# Autodesk Inventor assembly: Cantoneira montada perfil x prateleira
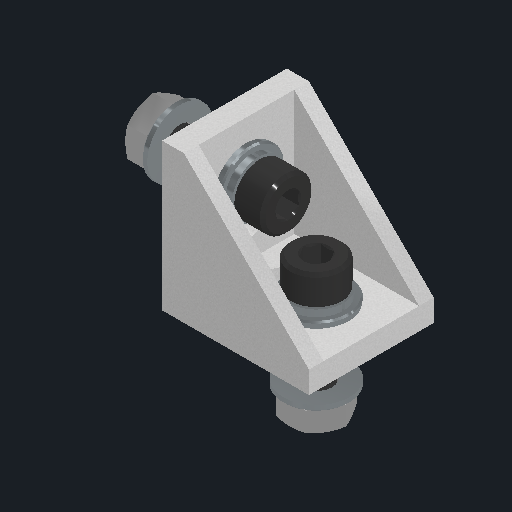
[picture p0: Inventor's stored thumbnail of the model, 512x512]
Saved by Autodesk Inventor 2026.1 (Build 301233000, 233)
## iProperties
Created: 2025-07-09
Part Number: Cantoneira montada perfil x prateleira
Document SubType Name: Assembly
Designer: Cliente
Mass: 13.7619 g
Surface Area: 41.0933 cm^2
Volume: 3.20103 cm^3
Density: 4.29922 g/cm^3
Author: Cliente
## Documents named in this file (6)
- C:\Users\Cliente\Desktop\TCC\Base\Fixação\Cantoneira montada manipulador.iam
- C:\Users\Cliente\Desktop\TCC\Base\Fixação\Cantoneira em alumínio 20X20X17.ipt
- C:\Users\Cliente\Desktop\TCC\Base\Fixação\Arruela Lisa DIN 125 - B4 - 300 HV.ipt
- C:\Users\Cliente\Desktop\TCC\Base\Fixação\Arruela de Pressão DIN 127 - B4.ipt
- C:\Users\Cliente\Desktop\TCC\Base\Fixação\Parafuso Allen Cabeça Cilíndrica DIN 912 - M4 - 12.9.ipt
- C:\Users\Cliente\Desktop\TCC\Base\Fixação\Porca Sextavada DIN 934 - M4 - 8.ipt
## Components (11 placed, 5 different names)
1. Cantoneira em alumínio 20X20X17:1 — Alinhado:1, Alinhado:2, Alinhado:3, Coincidente:1, Coincidente:2, Tangente:1, Tangente:2, Coincidente:14, Coincidente:17, Ângulo:1, Ângulo:2
2. Arruela Lisa DIN 125 - B4 - 300 HV:1 — Coincidente:1, Alinhado:4, Coincidente:6, Coincidente:7, Coincidente:11
3. Arruela Lisa DIN 125 - B4 - 300 HV:2 — Alinhado:5, Coincidente:2, Coincidente:3, Coincidente:4, Coincidente:8
4. Arruela de Pressão DIN 127 - B4:1 — Coincidente:3, Coincidente:4, Coincidente:5, Coincidente:9
5. Arruela de Pressão DIN 127 - B4:2 — Coincidente:6, Coincidente:7, Alinhado:6, Coincidente:10
6. Parafuso Allen Cabeça Cilíndrica DIN 912 - M4 - 12.9:1 — Alinhado:7, Coincidente:8, Coincidente:9, Tangente:1, Coincidente:15, Coincidente:18
7. Parafuso Allen Cabeça Cilíndrica DIN 912 - M4 - 12.9:2 — Alinhado:8, Coincidente:10, Coincidente:11, Tangente:2, Coincidente:12, Coincidente:19
8. Arruela Lisa DIN 125 - B4 - 300 HV:3 — Coincidente:12, Coincidente:13, Coincidente:14, Coincidente:20
9. Arruela Lisa DIN 125 - B4 - 300 HV:4 — Coincidente:15, Coincidente:16, Coincidente:17, Coincidente:21
10. Porca Sextavada DIN 934 - M4 - 8:1 — Coincidente:18, Ângulo:1, Coincidente:21
11. Porca Sextavada DIN 934 - M4 - 8:2 — Coincidente:19, Ângulo:2, Coincidente:20
## Relationships (33: Mate 21, Flush 8, Tangent 2, Angle 2)
- Alinhado:1 [Flush]: Cantoneira em alumínio 20X20X17:1
- Alinhado:2 [Flush]: Cantoneira em alumínio 20X20X17:1
- Alinhado:3 [Flush]: Cantoneira em alumínio 20X20X17:1
- Coincidente:1 [Mate]: Cantoneira em alumínio 20X20X17:1 ↔ Arruela Lisa DIN 125 - B4 - 300 HV:1
- Alinhado:4 [Flush]: Arruela Lisa DIN 125 - B4 - 300 HV:1
- Alinhado:5 [Flush]: Arruela Lisa DIN 125 - B4 - 300 HV:2
- Coincidente:2 [Mate]: Cantoneira em alumínio 20X20X17:1 ↔ Arruela Lisa DIN 125 - B4 - 300 HV:2
- Coincidente:3 [Mate]: Arruela Lisa DIN 125 - B4 - 300 HV:2 ↔ Arruela de Pressão DIN 127 - B4:1
- Coincidente:4 [Mate]: Arruela Lisa DIN 125 - B4 - 300 HV:2 ↔ Arruela de Pressão DIN 127 - B4:1
- Coincidente:5 [Mate]: Arruela de Pressão DIN 127 - B4:1
- Coincidente:6 [Mate]: Arruela Lisa DIN 125 - B4 - 300 HV:1 ↔ Arruela de Pressão DIN 127 - B4:2
- Coincidente:7 [Mate]: Arruela Lisa DIN 125 - B4 - 300 HV:1 ↔ Arruela de Pressão DIN 127 - B4:2
- Alinhado:6 [Flush]: Arruela de Pressão DIN 127 - B4:2
- Alinhado:7 [Flush]: Parafuso Allen Cabeça Cilíndrica DIN 912 - M4 - 12.9:1
- Coincidente:8 [Mate]: Arruela Lisa DIN 125 - B4 - 300 HV:2 ↔ Parafuso Allen Cabeça Cilíndrica DIN 912 - M4 - 12.9:1
- Coincidente:9 [Mate]: Arruela de Pressão DIN 127 - B4:1 ↔ Parafuso Allen Cabeça Cilíndrica DIN 912 - M4 - 12.9:1
- Tangente:1: Cantoneira em alumínio 20X20X17:1 ↔ Parafuso Allen Cabeça Cilíndrica DIN 912 - M4 - 12.9:1
- Alinhado:8 [Flush]: Parafuso Allen Cabeça Cilíndrica DIN 912 - M4 - 12.9:2
- Coincidente:10 [Mate]: Arruela de Pressão DIN 127 - B4:2 ↔ Parafuso Allen Cabeça Cilíndrica DIN 912 - M4 - 12.9:2
- Coincidente:11 [Mate]: Arruela Lisa DIN 125 - B4 - 300 HV:1 ↔ Parafuso Allen Cabeça Cilíndrica DIN 912 - M4 - 12.9:2
- Tangente:2: Cantoneira em alumínio 20X20X17:1 ↔ Parafuso Allen Cabeça Cilíndrica DIN 912 - M4 - 12.9:2
- Coincidente:12 [Mate]: Parafuso Allen Cabeça Cilíndrica DIN 912 - M4 - 12.9:2 ↔ Arruela Lisa DIN 125 - B4 - 300 HV:3
- Coincidente:13 [Mate]: Arruela Lisa DIN 125 - B4 - 300 HV:3
- Coincidente:14 [Mate] (6 mm): Cantoneira em alumínio 20X20X17:1 ↔ Arruela Lisa DIN 125 - B4 - 300 HV:3
- Coincidente:15 [Mate]: Parafuso Allen Cabeça Cilíndrica DIN 912 - M4 - 12.9:1 ↔ Arruela Lisa DIN 125 - B4 - 300 HV:4
- Coincidente:16 [Mate]: Arruela Lisa DIN 125 - B4 - 300 HV:4
- Coincidente:17 [Mate] (6 mm): Cantoneira em alumínio 20X20X17:1 ↔ Arruela Lisa DIN 125 - B4 - 300 HV:4
- Coincidente:18 [Mate]: Parafuso Allen Cabeça Cilíndrica DIN 912 - M4 - 12.9:1 ↔ Porca Sextavada DIN 934 - M4 - 8:1
- Ângulo:1 [Angle] (0 deg): Cantoneira em alumínio 20X20X17:1 ↔ Porca Sextavada DIN 934 - M4 - 8:1
- Coincidente:19 [Mate]: Parafuso Allen Cabeça Cilíndrica DIN 912 - M4 - 12.9:2 ↔ Porca Sextavada DIN 934 - M4 - 8:2
- Ângulo:2 [Angle] (0 deg): Cantoneira em alumínio 20X20X17:1 ↔ Porca Sextavada DIN 934 - M4 - 8:2
- Coincidente:20 [Mate]: Arruela Lisa DIN 125 - B4 - 300 HV:3 ↔ Porca Sextavada DIN 934 - M4 - 8:2
- Coincidente:21 [Mate]: Arruela Lisa DIN 125 - B4 - 300 HV:4 ↔ Porca Sextavada DIN 934 - M4 - 8:1
